# Autodesk Inventor assembly: assembly
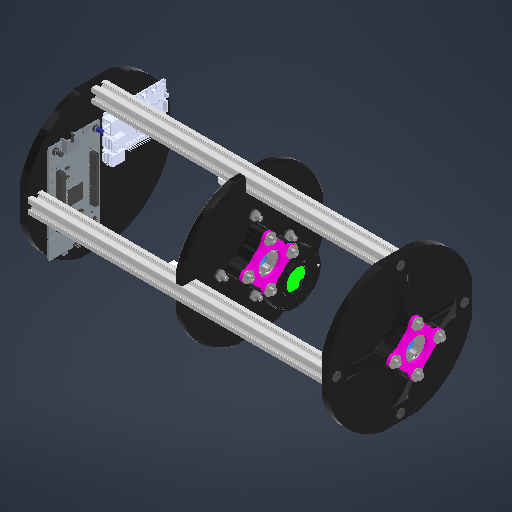
[picture p0: Inventor's stored thumbnail of the model, 512x512]
Saved by Autodesk Inventor 2027.1 (Build 311270010, 270A)
## iProperties
Created: 2026-10-07
Part Number: assembly
Document SubType Name: Assembly
Designer: luca
Author: luca
## Documents named in this file (21)
- C:\Users\lucao\Desktop\RL-Rotary-Inverted-Double-Pendulum\CAD\AssemblyBase.iam
- C:\Users\lucao\Desktop\RL-Rotary-Inverted-Double-Pendulum\CAD\Electronics\RASPBERRY_PI_5\RASPBERRY_PI_5.ipt
- C:\Users\lucao\Desktop\RL-Rotary-Inverted-Double-Pendulum\CAD\Electronics\stm32\NUCLEO-F429ZI--3DModel-STEP-56544\NUCLEO-F429ZI--3DModel-STEP-56544.ipt
- C:\Users\lucao\Desktop\RL-Rotary-Inverted-Double-Pendulum\CAD\al-profil-20x20-drazka-6\al-profil-20x20-drazka-6.ipt
- C:\Users\lucao\Desktop\RL-Rotary-Inverted-Double-Pendulum\CAD\plate_lower.ipt
- C:\Users\lucao\Desktop\RL-Rotary-Inverted-Double-Pendulum\CAD\plate_middle.ipt
- C:\Users\lucao\Desktop\RL-Rotary-Inverted-Double-Pendulum\CAD\plate_upper.ipt
- C:\Users\lucao\Desktop\RL-Rotary-Inverted-Double-Pendulum\CAD\90_Deg_Profile\90_Deg_Profile.ipt
- C:\Users\lucao\Documents\Inventor\Content Center Files\R2027\en-US\DIN 625 - T1\DIN 625 T1 - 16003 - 17 x 35 x 8.ipt
- C:\Users\lucao\Desktop\RL-Rotary-Inverted-Double-Pendulum\CAD\bearing_lock_middleplate_upper.ipt
- C:\Users\lucao\Desktop\RL-Rotary-Inverted-Double-Pendulum\CAD\bearing_distancer_middle.ipt
- C:\Users\lucao\Documents\Inventor\Content Center Files\R2027\en-US\DIN 9021\DIN 9021 - 5,3.ipt
- C:\Users\lucao\Documents\Inventor\Content Center Files\R2027\en-US\ISO 4762(1)\DIN EN ISO 4762 - M5 x 40.ipt
- C:\Users\lucao\Documents\Inventor\Content Center Files\R2027\en-US\ISO 4032(1)\ISO 4032 - M5DIN EN.ipt
- C:\Users\lucao\Documents\Inventor\Content Center Files\R2027\en-US\ISO 4762(1)\DIN EN ISO 4762 - M3 x 16.ipt
- C:\Users\lucao\Documents\Inventor\Content Center Files\R2027\en-US\DIN EN ISO 7091\DIN EN ISO 7091 - 3.ipt
- C:\Users\lucao\Documents\Inventor\Content Center Files\R2027\en-US\ISO 10642(2)\ISO 10642  - M6  x  45.ipt
- C:\Users\lucao\Documents\Inventor\Content Center Files\R2027\en-US\ISO 4762(1)\DIN EN ISO 4762 - M6 x 25.ipt
- C:\Users\lucao\Documents\Inventor\Content Center Files\R2027\en-US\ISO 7091\ISO 7091 - ST 6 - 100 HV.ipt
- C:\Users\lucao\Documents\Inventor\Content Center Files\R2027\en-US\ISO 4036(1)\ISO 4036 - M6(1).ipt
- C:\Users\lucao\Desktop\RL-Rotary-Inverted-Double-Pendulum\CAD\motor_stationary_part.iam
## Components (82 placed, 20 different names)
1. motor_stationary_part:1 [sub-assembly] — Mate:145, Mate:146, Mate:147, Mate:148, Mate:149, Tangent:1, Flush:2
2. RASPBERRY_PI_5:1 — Mate:7
3. NUCLEO-F429ZI--3DModel-STEP-56544:1 — Mate:6
4. DIN 625 - T1 16003 - 17 x 35 x 8:4 — Mate:132, Mate:133
5. DIN 625 - T1 16003 - 17 x 35 x 8:3 — Mate:129, Mate:131
6. DIN 625 - T1 16003 - 17 x 35 x 8:2 — Mate:63, Mate:69
7. DIN 625 - T1 16003 - 17 x 35 x 8:1 — Mate:65, Mate:67, Mate:70
8. DIN EN 24032 M5:4 — Insert:22
9. DIN EN 24032 M5:3 — Insert:21
10. DIN EN 24032 M5:2 — Insert:20
11. DIN EN 24032 M5:1 — Insert:19
12. DIN EN ISO 7091 3:4 — Mate:85, Mate:86, Mate:90
13. DIN EN ISO 7091 3:3 — Mate:83, Mate:84, Mate:89
14. DIN EN ISO 7091 3:2 — Mate:81, Mate:82, Mate:87
15. DIN EN ISO 7091 3:1 — Mate:79, Mate:80, Mate:88
16. DIN EN ISO 4762 M3 x 16:4 — Mate:79, Mate:88, Mate:145
17. DIN EN ISO 4762 M3 x 16:3 — Mate:83, Mate:89, Mate:149
18. DIN EN ISO 4762 M3 x 16:2 — Mate:85, Mate:90, Mate:148
19. DIN EN ISO 4762 M3 x 16:1 — Mate:81, Mate:87, Mate:146
20. bearing_distancer_middle:2 — Mate:131, Mate:132
21. bearing_distancer_middle:1 — Mate:69, Mate:70
22. plate_lower:1 — Mate:1, Mate:2, Mate:3, Mate:4, Mate:5, Angle:1, Mate:6, Mate:7, Mate:17, Mate:19, Mate:98, Mate:99, Mate:100, Mate:101
23. DIN EN ISO 10642 M6  x  45:4 — Mate:97
24. DIN EN ISO 10642 M6  x  45:2 — Mate:95
25. DIN EN ISO 10642 M6  x  45:1 — Mate:94
26. DIN EN ISO 10642 M6  x  45:3 — Mate:96
27. DIN EN ISO 10642 M6  x  45:6 — Mate:99
28. DIN EN ISO 10642 M6  x  45:7 — Mate:100
29. DIN EN ISO 10642 M6  x  45:5 — Mate:98
30. DIN EN ISO 10642 M6  x  45:8 — Mate:101
31. plate_middle:1 — Mate:17, Mate:19, Angle:2, Mate:42, Mate:62, Mate:67, Insert:14, Mate:80, Mate:82, Mate:84, Mate:86, Mate:102, Mate:104, Mate:106, Mate:108, Mate:111, Mate:113, Mate:115, Mate:117, Mate:147, Tangent:1
32. plate_upper:1 — Mate:18, Mate:20, Mate:21, Angle:3, Mate:94, Mate:95, Mate:96, Mate:97, Mate:133, Mate:134, Mate:142
33. bearing_lock_middleplate_upper:1 — Mate:62, Mate:63, Insert:10, Insert:11, Insert:12, Insert:13
34. DIN 9021 5,3:1 — Insert:10, Insert:18
35. DIN 9021 5,3:2 — Insert:11, Insert:17
36. DIN 9021 5,3:3 — Insert:12, Insert:15
37. DIN 9021 5,3:4 — Insert:13, Insert:16
38. DIN EN ISO 4762 M5 x 40:1 — Insert:15
39. DIN EN ISO 4762 M5 x 40:2 — Insert:16
40. DIN EN ISO 4762 M5 x 40:3 — Insert:17
41. DIN EN ISO 4762 M5 x 40:4 — Insert:18
42. DIN EN ISO 4762 M6 x 25:1 — Mate:102, Mate:103, Mate:110, Mate:120
43. DIN EN ISO 4762 M6 x 25:2 — Mate:104, Mate:105, Mate:116, Mate:118
44. DIN EN ISO 4762 M6 x 25:3 — Mate:106, Mate:107, Mate:114, Mate:122
45. DIN EN ISO 4762 M6 x 25:4 — Mate:108, Mate:109, Mate:112, Mate:124
46. ISO 7091 ST 6 - 100 HV:1 — Mate:110, Mate:111, Mate:121
47. ISO 7091 ST 6 - 100 HV:2 — Mate:112, Mate:113, Mate:125
48. ISO 7091 ST 6 - 100 HV:3 — Mate:114, Mate:115, Mate:123
49. ISO 7091 ST 6 - 100 HV:4 — Mate:116, Mate:117, Mate:119
50. DIN EN 24036 M6:1 — Mate:118, Mate:119
51. DIN EN 24036 M6:2 — Mate:120, Mate:121
52. DIN EN 24036 M6:3 — Mate:122, Mate:123
53. DIN EN 24036 M6:4 — Mate:124, Mate:125
54. bearing_lock_middleplate_upper:2 — Mate:129, Mate:134, Mate:137, Mate:139
55. DIN 9021 5,3:5 — Insert:14, Insert:22
56. DIN 9021 5,3:6 — Insert:21
57. DIN 9021 5,3:7 — Insert:20
58. DIN 9021 5,3:8 — Insert:19
59. al-profil-20x20-drazka-6:1 — Mate:4, Mate:5, Angle:1, Mate:20, Mate:21
60. al-profil-20x20-drazka-6:2 — Mate:18, Angle:2, Angle:3
61. al-profil-20x20-drazka-6:3
62. al-profil-20x20-drazka-6:4 — Flush:1, Mate:43
63. 90_Deg_Profile:1 — Mate:42, Flush:1, Mate:43, Mate:103, Mate:105, Mate:107, Mate:109
64. 90_Deg_Profile:2
65. 90_Deg_Profile:3
66. 90_Deg_Profile:4
67. DIN EN 24032 M5:5 — Mate:143, Mate:144
68. DIN EN ISO 4762 M5 x 40:5 — Mate:137, Mate:138, Mate:140, Mate:141, Mate:144
69. DIN 9021 5,3:10 — Mate:141, Mate:142, Mate:143
70. DIN 9021 5,3:9 — Mate:138, Mate:139, Mate:140
71. DIN EN 24032 M5:6
72. DIN EN ISO 4762 M5 x 40:6
73. DIN 9021 5,3:11
74. DIN 9021 5,3:12
75. DIN EN 24032 M5:7
76. DIN EN ISO 4762 M5 x 40:7
77. DIN 9021 5,3:13
78. DIN 9021 5,3:14
79. DIN EN 24032 M5:8
80. DIN EN ISO 4762 M5 x 40:8
81. DIN 9021 5,3:15
82. DIN 9021 5,3:16
## Component patterns: (4 elements, first: DIN 9021 5,3:5), (4 elements, first: al-profil-20x20-drazka-6:1), (4 elements, first: 90_Deg_Profile:1), (4 elements, first: DIN EN 24032 M5:5 + DIN EN ISO 4762 M5 x 40:5 + DIN 9021 5,3:10 + DIN 9021 5,3:9)
## Relationships (103: Mate 83, Insert 13, Angle 4, Flush 2, Tangent 1)
- Mate:1: plate_lower:1
- Mate:2: plate_lower:1
- Mate:3: plate_lower:1
- Mate:4: plate_lower:1 ↔ al-profil-20x20-drazka-6:1
- Mate:5: plate_lower:1 ↔ al-profil-20x20-drazka-6:1
- Angle:1 (0 deg): plate_lower:1 ↔ al-profil-20x20-drazka-6:1
- Mate:6: NUCLEO-F429ZI--3DModel-STEP-56544:1 ↔ plate_lower:1
- Mate:7: RASPBERRY_PI_5:1 ↔ plate_lower:1
- Mate:17 (200 mm): plate_lower:1 ↔ plate_middle:1
- Mate:18: plate_upper:1 ↔ al-profil-20x20-drazka-6:2
- Mate:19: plate_lower:1 ↔ plate_middle:1
- Angle:2 (0 deg): plate_middle:1 ↔ al-profil-20x20-drazka-6:2
- Mate:20: plate_upper:1 ↔ al-profil-20x20-drazka-6:1
- Mate:21: plate_upper:1 ↔ al-profil-20x20-drazka-6:1
- Angle:3 (0 deg): plate_upper:1 ↔ al-profil-20x20-drazka-6:2
- Mate:42: plate_middle:1 ↔ 90_Deg_Profile:1
- Flush:1: al-profil-20x20-drazka-6:4 ↔ 90_Deg_Profile:1
- Mate:43: al-profil-20x20-drazka-6:4 ↔ 90_Deg_Profile:1
- Mate:62: plate_middle:1 ↔ bearing_lock_middleplate_upper:1
- Mate:63: DIN 625 - T1 16003 - 17 x 35 x 8:2 ↔ bearing_lock_middleplate_upper:1
- Mate:65: DIN 625 - T1 16003 - 17 x 35 x 8:1
- Mate:67: DIN 625 - T1 16003 - 17 x 35 x 8:1 ↔ plate_middle:1
- Mate:69: DIN 625 - T1 16003 - 17 x 35 x 8:2 ↔ bearing_distancer_middle:1
- Mate:70: DIN 625 - T1 16003 - 17 x 35 x 8:1 ↔ bearing_distancer_middle:1
- Insert:10: bearing_lock_middleplate_upper:1 ↔ DIN 9021 5,3:1
- Insert:11: bearing_lock_middleplate_upper:1 ↔ DIN 9021 5,3:2
- Insert:12: bearing_lock_middleplate_upper:1 ↔ DIN 9021 5,3:3
- Insert:13: bearing_lock_middleplate_upper:1 ↔ DIN 9021 5,3:4
- Insert:14: plate_middle:1 ↔ DIN 9021 5,3:5
- Insert:15: DIN 9021 5,3:3 ↔ DIN EN ISO 4762 M5 x 40:1
- Insert:16: DIN 9021 5,3:4 ↔ DIN EN ISO 4762 M5 x 40:2
- Insert:17: DIN 9021 5,3:2 ↔ DIN EN ISO 4762 M5 x 40:3
- Insert:18: DIN 9021 5,3:1 ↔ DIN EN ISO 4762 M5 x 40:4
- Insert:19: DIN EN 24032 M5:1 ↔ DIN 9021 5,3:8
- Insert:20: DIN EN 24032 M5:2 ↔ DIN 9021 5,3:7
- Insert:21: DIN EN 24032 M5:3 ↔ DIN 9021 5,3:6
- Insert:22: DIN EN 24032 M5:4 ↔ DIN 9021 5,3:5
- Mate:73
- Angle:5 (-45 deg)
- Mate:79: DIN EN ISO 7091 3:1 ↔ DIN EN ISO 4762 M3 x 16:4
- Mate:80: DIN EN ISO 7091 3:1 ↔ plate_middle:1
- Mate:81: DIN EN ISO 7091 3:2 ↔ DIN EN ISO 4762 M3 x 16:1
- Mate:82: DIN EN ISO 7091 3:2 ↔ plate_middle:1
- Mate:83: DIN EN ISO 7091 3:3 ↔ DIN EN ISO 4762 M3 x 16:3
- Mate:84: DIN EN ISO 7091 3:3 ↔ plate_middle:1
- Mate:85: DIN EN ISO 7091 3:4 ↔ DIN EN ISO 4762 M3 x 16:2
- Mate:86: DIN EN ISO 7091 3:4 ↔ plate_middle:1
- Mate:87: DIN EN ISO 7091 3:2 ↔ DIN EN ISO 4762 M3 x 16:1
- Mate:88: DIN EN ISO 7091 3:1 ↔ DIN EN ISO 4762 M3 x 16:4
- Mate:89: DIN EN ISO 7091 3:3 ↔ DIN EN ISO 4762 M3 x 16:3
- Mate:90: DIN EN ISO 7091 3:4 ↔ DIN EN ISO 4762 M3 x 16:2
- Mate:94: DIN EN ISO 10642 M6  x  45:1 ↔ plate_upper:1
- Mate:95: DIN EN ISO 10642 M6  x  45:2 ↔ plate_upper:1
- Mate:96: DIN EN ISO 10642 M6  x  45:3 ↔ plate_upper:1
- Mate:97: DIN EN ISO 10642 M6  x  45:4 ↔ plate_upper:1
- Mate:98: plate_lower:1 ↔ DIN EN ISO 10642 M6  x  45:5
- Mate:99: plate_lower:1 ↔ DIN EN ISO 10642 M6  x  45:6
- Mate:100: plate_lower:1 ↔ DIN EN ISO 10642 M6  x  45:7
- Mate:101: plate_lower:1 ↔ DIN EN ISO 10642 M6  x  45:8
- Mate:102: plate_middle:1 ↔ DIN EN ISO 4762 M6 x 25:1
- Mate:103: DIN EN ISO 4762 M6 x 25:1 ↔ 90_Deg_Profile:1
- Mate:104: plate_middle:1 ↔ DIN EN ISO 4762 M6 x 25:2
- Mate:105: DIN EN ISO 4762 M6 x 25:2 ↔ 90_Deg_Profile:1
- Mate:106: plate_middle:1 ↔ DIN EN ISO 4762 M6 x 25:3
- Mate:107: DIN EN ISO 4762 M6 x 25:3 ↔ 90_Deg_Profile:1
- Mate:108: plate_middle:1 ↔ DIN EN ISO 4762 M6 x 25:4
- Mate:109: DIN EN ISO 4762 M6 x 25:4 ↔ 90_Deg_Profile:1
- Mate:110: DIN EN ISO 4762 M6 x 25:1 ↔ ISO 7091 ST 6 - 100 HV:1
- Mate:111: plate_middle:1 ↔ ISO 7091 ST 6 - 100 HV:1
- Mate:112: DIN EN ISO 4762 M6 x 25:4 ↔ ISO 7091 ST 6 - 100 HV:2
- Mate:113: plate_middle:1 ↔ ISO 7091 ST 6 - 100 HV:2
- Mate:114: DIN EN ISO 4762 M6 x 25:3 ↔ ISO 7091 ST 6 - 100 HV:3
- Mate:115: plate_middle:1 ↔ ISO 7091 ST 6 - 100 HV:3
- Mate:116: DIN EN ISO 4762 M6 x 25:2 ↔ ISO 7091 ST 6 - 100 HV:4
- Mate:117: plate_middle:1 ↔ ISO 7091 ST 6 - 100 HV:4
- Mate:118: DIN EN ISO 4762 M6 x 25:2 ↔ DIN EN 24036 M6:1
- Mate:119: ISO 7091 ST 6 - 100 HV:4 ↔ DIN EN 24036 M6:1
- Mate:120: DIN EN ISO 4762 M6 x 25:1 ↔ DIN EN 24036 M6:2
- Mate:121: ISO 7091 ST 6 - 100 HV:1 ↔ DIN EN 24036 M6:2
- Mate:122: DIN EN ISO 4762 M6 x 25:3 ↔ DIN EN 24036 M6:3
- Mate:123: ISO 7091 ST 6 - 100 HV:3 ↔ DIN EN 24036 M6:3
- Mate:124: DIN EN ISO 4762 M6 x 25:4 ↔ DIN EN 24036 M6:4
- Mate:125: ISO 7091 ST 6 - 100 HV:2 ↔ DIN EN 24036 M6:4
- Mate:129: DIN 625 - T1 16003 - 17 x 35 x 8:3 ↔ bearing_lock_middleplate_upper:2
- Mate:131: DIN 625 - T1 16003 - 17 x 35 x 8:3 ↔ bearing_distancer_middle:2
- Mate:132: DIN 625 - T1 16003 - 17 x 35 x 8:4 ↔ bearing_distancer_middle:2
- Mate:133: DIN 625 - T1 16003 - 17 x 35 x 8:4 ↔ plate_upper:1
- Mate:134: plate_upper:1 ↔ bearing_lock_middleplate_upper:2
- Mate:137: bearing_lock_middleplate_upper:2 ↔ DIN EN ISO 4762 M5 x 40:5
- Mate:138: DIN EN ISO 4762 M5 x 40:5 ↔ DIN 9021 5,3:9
- Mate:139: bearing_lock_middleplate_upper:2 ↔ DIN 9021 5,3:9
- Mate:140: DIN EN ISO 4762 M5 x 40:5 ↔ DIN 9021 5,3:9
- Mate:141: DIN EN ISO 4762 M5 x 40:5 ↔ DIN 9021 5,3:10
- Mate:142: plate_upper:1 ↔ DIN 9021 5,3:10
- Mate:143: DIN EN 24032 M5:5 ↔ DIN 9021 5,3:10
- Mate:144: DIN EN 24032 M5:5 ↔ DIN EN ISO 4762 M5 x 40:5
- Mate:145: motor_stationary_part:1 ↔ DIN EN ISO 4762 M3 x 16:4
- Mate:146: motor_stationary_part:1 ↔ DIN EN ISO 4762 M3 x 16:1
- Mate:147: motor_stationary_part:1 ↔ plate_middle:1
- Mate:148: motor_stationary_part:1 ↔ DIN EN ISO 4762 M3 x 16:2
- Mate:149: motor_stationary_part:1 ↔ DIN EN ISO 4762 M3 x 16:3
- Tangent:1: motor_stationary_part:1 ↔ plate_middle:1
- Flush:2: motor_stationary_part:1
